# Autodesk Inventor assembly: SPE6V1 Roldana Acrilico
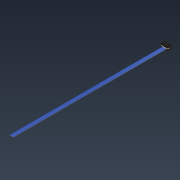
[picture p0: Inventor's stored thumbnail of the model, 180x180]
Saved by Autodesk Inventor 2021.2 (Build 252289000, 289)
## iProperties
Created: 2026-09-01
Part Number: SPE6V1 Roldana Acrilico
Document SubType Name: Assembly
Designer: nelso
Mass: 602.524 g
Surface Area: 3556.14 cm^2
Volume: 516.501 cm^3
Density: 1.16655 g/cm^3
Author: nelso
## Documents named in this file (7)
- C:\Users\Tecnica\OneDrive\Documentos\Mecanica\Soporte-Paciente-Espinografia\Workspace\SPE6V1 Roldana Acrilico.iam
- C:\Users\Tecnica\OneDrive\Documentos\Mecanica\Soporte-Paciente-Espinografia\Workspace\SP53V1 Felpa Roldana.ipt
- C:\Users\Tecnica\OneDrive\Documentos\Mecanica\Soporte-Paciente-Espinografia\Workspace\SP55V1 Acrilico superior.ipt
- C:\Users\Tecnica\OneDrive\Documentos\Mecanica\Soporte-Paciente-Espinografia\Workspace\SP52V1 Plastico Roldana.ipt
- C:\Users\Tecnica\OneDrive\Documentos\Mecanica\Soporte-Paciente-Espinografia\Workspace\DIN555-5M4X0.8I.ipt
- C:\Users\Tecnica\OneDrive\Documentos\Mecanica\Soporte-Paciente-Espinografia\Workspace\DIN7991M4X0.8L16C.ipt
- C:\Users\Tecnica\OneDrive\Documentos\Mecanica\Soporte-Paciente-Espinografia\Workspace\SP54V1 Acrilico inferior.ipt
## Components (9 placed, 6 different names)
1. SP52V1 Plastico Roldana:1 — Flush:14, Mate:14, Mate:15, Mate:16, Mate:17, Mate:23, Mate:25, Mate:26, Mate:32, Mate:33, Mate:34
2. SP53V1 Felpa Roldana:1 — Mate:14, Mate:17, Mate:19
3. SP53V1 Felpa Roldana:2 — Mate:15, Mate:16, Flush:15
4. SP54V1 Acrilico inferior:1 — Mate:27, Mate:28, Mate:29, Mate:30, Mate:31, Mate:34
5. SP55V1 Acrilico superior:1 — Flush:3, Flush:4, Mate:27, Mate:28, Mate:29
6. DIN555-5M4X0.8I:1 — Mate:24, Mate:25
7. DIN555-5M4X0.8I:2 — Mate:22, Mate:23
8. DIN7991M4X0.8L16C:1 — Flush:3, Mate:22, Mate:30, Mate:32
9. DIN7991M4X0.8L16C:2 — Flush:4, Mate:24, Mate:31, Mate:33
## Relationships (22: Mate 18, Flush 4)
- Flush:3: SP55V1 Acrilico superior:1 ↔ DIN7991M4X0.8L16C:1
- Flush:4: SP55V1 Acrilico superior:1 ↔ DIN7991M4X0.8L16C:2
- Flush:14: SP52V1 Plastico Roldana:1
- Mate:14: SP52V1 Plastico Roldana:1 ↔ SP53V1 Felpa Roldana:1
- Mate:15: SP52V1 Plastico Roldana:1 ↔ SP53V1 Felpa Roldana:2
- Mate:16: SP52V1 Plastico Roldana:1 ↔ SP53V1 Felpa Roldana:2
- Mate:17: SP52V1 Plastico Roldana:1 ↔ SP53V1 Felpa Roldana:1
- Mate:19: SP53V1 Felpa Roldana:1
- Flush:15: SP53V1 Felpa Roldana:2
- Mate:22: DIN555-5M4X0.8I:2 ↔ DIN7991M4X0.8L16C:1
- Mate:23: SP52V1 Plastico Roldana:1 ↔ DIN555-5M4X0.8I:2
- Mate:24: DIN555-5M4X0.8I:1 ↔ DIN7991M4X0.8L16C:2
- Mate:25: SP52V1 Plastico Roldana:1 ↔ DIN555-5M4X0.8I:1
- Mate:26: SP52V1 Plastico Roldana:1
- Mate:27: SP54V1 Acrilico inferior:1 ↔ SP55V1 Acrilico superior:1
- Mate:28: SP54V1 Acrilico inferior:1 ↔ SP55V1 Acrilico superior:1
- Mate:29: SP54V1 Acrilico inferior:1 ↔ SP55V1 Acrilico superior:1
- Mate:30: SP54V1 Acrilico inferior:1 ↔ DIN7991M4X0.8L16C:1
- Mate:31: SP54V1 Acrilico inferior:1 ↔ DIN7991M4X0.8L16C:2
- Mate:32: SP52V1 Plastico Roldana:1 ↔ DIN7991M4X0.8L16C:1
- Mate:33: SP52V1 Plastico Roldana:1 ↔ DIN7991M4X0.8L16C:2
- Mate:34: SP52V1 Plastico Roldana:1 ↔ SP54V1 Acrilico inferior:1
